# Autodesk Inventor assembly: test-model-24BYG_1
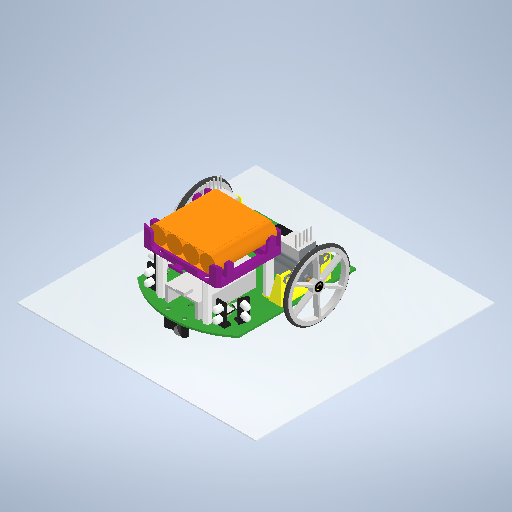
[picture p0: Inventor's stored thumbnail of the model, 512x512]
Saved by Autodesk Inventor 2025.3 (Build 293356000, 356)
## iProperties
Created: 2025-05-29
Part Number: test-model-24BYG_1
Document SubType Name: Assembly
Designer: yamashita1
Author: yamashita1
## Documents named in this file (14)
- G:\マイドライブ\project\micro-mouse\3D-Model\test-model-24BYG_1.iam
- G:\マイドライブ\project\micro-mouse\3D-Model\BallCaster-H16.ipt
- G:\マイドライブ\project\micro-mouse\3D-Model\Photo-Sensor.iam
- G:\マイドライブ\project\micro-mouse\3D-Model\ESP32-DevKitC.ipt
- G:\マイドライブ\project\micro-mouse\3D-Model\AQM1602Y.ipt
- G:\マイドライブ\project\micro-mouse\3D-Model\BaseBoard-stp3.ipt
- G:\マイドライブ\project\micro-mouse\3D-Model\Spacer-M3H30.ipt
- G:\マイドライブ\project\micro-mouse\3D-Model\Ground.ipt
- G:\マイドライブ\project\micro-mouse\3D-Model\Battery-Holder3-1x4.ipt
- G:\マイドライブ\project\micro-mouse\3D-Model\NiMH-Battery.ipt
- G:\マイドライブ\project\micro-mouse\3D-Model\24BYG-48_Braket1.ipt
- G:\マイドライブ\project\micro-mouse\3D-Model\24BYG-48.ipt
- G:\マイドライブ\project\micro-mouse\3D-Model\Wheel-D55A.ipt
- G:\マイドライブ\project\micro-mouse\3D-Model\O-ring_D55.ipt
## Components (23 placed, 13 different names)
1. BallCaster-H16:1 — メイト:7, メイト:8, メイト:9
2. Photo-Sensor:1 [sub-assembly] — メイト:15
3. Photo-Sensor:2 [sub-assembly] — メイト:14
4. Photo-Sensor:3 [sub-assembly] — メイト:12
5. Photo-Sensor:4 [sub-assembly] — メイト:13
6. ESP32-DevKitC:1 — メイト:10
7. AQM1602Y:1 — メイト:11
8. BaseBoard-stp3:1 — メイト:7, メイト:8, メイト:9, メイト:10, メイト:11, メイト:12, メイト:13, メイト:14, メイト:15, メイト:26, メイト:27, メイト:28, メイト:29, メイト:59, メイト:60, メイト:61, メイト:62, メイト:63, メイト:64, メイト:71, メイト:73
9. Spacer-M3H30:1 — メイト:26, メイト:28
10. Spacer-M3H30:2 — メイト:27, メイト:29, メイト:55
11. Spacer-M3H30:3 — メイト:54, メイト:56, メイト:73, メイト:74
12. Spacer-M3H30:4 — メイト:71, メイト:72
13. Ground:1
14. Battery-Holder3-1x4:1 — メイト:54, メイト:55, メイト:56, メイト:57, メイト:58
15. NiMH-Battery:1 — メイト:57, メイト:58
16. 24BYG-48_Braket1:1 — メイト:62, メイト:63, メイト:64, メイト:68, メイト:69, メイト:70, メイト:74
17. 24BYG-48_Braket1:2 — メイト:59, メイト:60, メイト:61, メイト:65, メイト:66, メイト:67, メイト:72
18. 24BYG-48:1 — メイト:68, メイト:69, メイト:70, メイト:77, フラッシュ:1
19. 24BYG-48:2 — メイト:65, メイト:66, メイト:67, メイト:78, フラッシュ:2
20. Wheel-D55A:1 — メイト:75, メイト:78, フラッシュ:2
21. Wheel-D55A:2 — メイト:76, メイト:77, フラッシュ:1
22. O-ring_D55:1 — メイト:75
23. O-ring_D55:2 — メイト:76
## Relationships (40: Mate 38, Flush 2)
- メイト:7 [Mate]: BallCaster-H16:1 ↔ BaseBoard-stp3:1
- メイト:8 [Mate]: BallCaster-H16:1 ↔ BaseBoard-stp3:1
- メイト:9 [Mate]: BallCaster-H16:1 ↔ BaseBoard-stp3:1
- メイト:10 [Mate]: ESP32-DevKitC:1 ↔ BaseBoard-stp3:1
- メイト:11 [Mate]: AQM1602Y:1 ↔ BaseBoard-stp3:1
- メイト:12 [Mate]: Photo-Sensor:3 ↔ BaseBoard-stp3:1
- メイト:13 [Mate]: Photo-Sensor:4 ↔ BaseBoard-stp3:1
- メイト:14 [Mate]: Photo-Sensor:2 ↔ BaseBoard-stp3:1
- メイト:15 [Mate]: Photo-Sensor:1 ↔ BaseBoard-stp3:1
- メイト:26 [Mate]: BaseBoard-stp3:1 ↔ Spacer-M3H30:1
- メイト:27 [Mate]: BaseBoard-stp3:1 ↔ Spacer-M3H30:2
- メイト:28 [Mate]: BaseBoard-stp3:1 ↔ Spacer-M3H30:1
- メイト:29 [Mate]: BaseBoard-stp3:1 ↔ Spacer-M3H30:2
- メイト:54 [Mate]: Spacer-M3H30:3 ↔ Battery-Holder3-1x4:1
- メイト:55 [Mate]: Spacer-M3H30:2 ↔ Battery-Holder3-1x4:1
- メイト:56 [Mate]: Spacer-M3H30:3 ↔ Battery-Holder3-1x4:1
- メイト:57 [Mate]: Battery-Holder3-1x4:1 ↔ NiMH-Battery:1
- メイト:58 [Mate]: Battery-Holder3-1x4:1 ↔ NiMH-Battery:1
- メイト:59 [Mate]: BaseBoard-stp3:1 ↔ 24BYG-48_Braket1:2
- メイト:60 [Mate]: BaseBoard-stp3:1 ↔ 24BYG-48_Braket1:2
- メイト:61 [Mate]: BaseBoard-stp3:1 ↔ 24BYG-48_Braket1:2
- メイト:62 [Mate]: BaseBoard-stp3:1 ↔ 24BYG-48_Braket1:1
- メイト:63 [Mate]: BaseBoard-stp3:1 ↔ 24BYG-48_Braket1:1
- メイト:64 [Mate]: BaseBoard-stp3:1 ↔ 24BYG-48_Braket1:1
- メイト:65 [Mate]: 24BYG-48_Braket1:2 ↔ 24BYG-48:2
- メイト:66 [Mate]: 24BYG-48_Braket1:2 ↔ 24BYG-48:2
- メイト:67 [Mate]: 24BYG-48_Braket1:2 ↔ 24BYG-48:2
- メイト:68 [Mate]: 24BYG-48_Braket1:1 ↔ 24BYG-48:1
- メイト:69 [Mate]: 24BYG-48_Braket1:1 ↔ 24BYG-48:1
- メイト:70 [Mate]: 24BYG-48_Braket1:1 ↔ 24BYG-48:1
- メイト:71 [Mate]: BaseBoard-stp3:1 ↔ Spacer-M3H30:4
- メイト:72 [Mate]: Spacer-M3H30:4 ↔ 24BYG-48_Braket1:2
- メイト:73 [Mate]: BaseBoard-stp3:1 ↔ Spacer-M3H30:3
- メイト:74 [Mate]: Spacer-M3H30:3 ↔ 24BYG-48_Braket1:1
- メイト:75 [Mate]: Wheel-D55A:1 ↔ O-ring_D55:1
- メイト:76 [Mate]: Wheel-D55A:2 ↔ O-ring_D55:2
- メイト:77 [Mate]: 24BYG-48:1 ↔ Wheel-D55A:2
- フラッシュ:1 [Flush]: 24BYG-48:1 ↔ Wheel-D55A:2
- メイト:78 [Mate]: 24BYG-48:2 ↔ Wheel-D55A:1
- フラッシュ:2 [Flush]: 24BYG-48:2 ↔ Wheel-D55A:1
